# Autodesk Inventor assembly: Assembly2
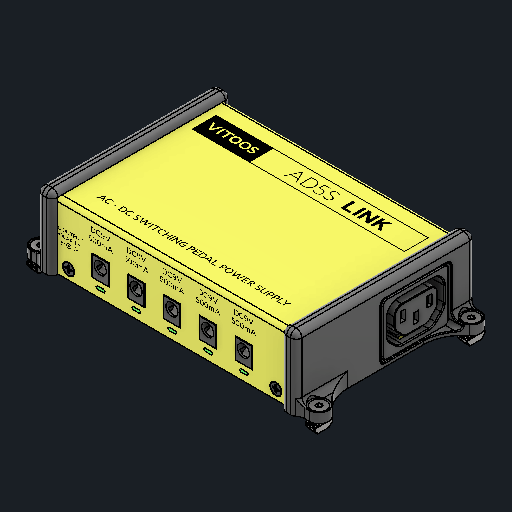
[picture p0: Inventor's stored thumbnail of the model, 512x512]
Saved by Autodesk Inventor 2026.2 (Build 302298000, 298)
## iProperties
Created: 2026-10-31
Part Number: Assembly2
Document SubType Name: Assembly
Designer: JoshuaEah
Author: JoshuaEah
## Documents named in this file (6)
- C:\Users\JoshuaEah\Documents\GitHub\designs\Guitar\Modular Pedalboard\Pedals\Power Supply\PSU Assembly.iam
- C:\Users\JoshuaEah\Documents\GitHub\designs\Guitar\Modular Pedalboard\Pedals\Power Supply\VITOOS AD5S LINK.iam
- C:\Users\JoshuaEah\Documents\GitHub\designs\Guitar\Modular Pedalboard\Pedals\Power Supply\PSU Bracket A.ipt
- C:\Users\JoshuaEah\Documents\GitHub\designs\Guitar\Modular Pedalboard\Pedals\Power Supply\PSU Bracket B.ipt
- C:\Users\JoshuaEah\Documents\GitHub\designs\Common Hardware\M4x0.7x10mm FHCS.ipt
- C:\Users\JoshuaEah\Documents\GitHub\designs\Common Hardware\M4x0.7 T-Slot Nut.ipt
## Components (11 placed, 5 different names)
1. VITOOS AD5S LINK:1 [sub-assembly] — Mate:3, Mate:4, Mate:8, Mate:9, Mate:10, Mate:11
2. PSU Bracket A:1 — Mate:3, Mate:4, Mate:8, Insert:1, Insert:2, Insert:5, Insert:6, Angle:1, Angle:2
3. PSU Bracket B:1 — Mate:9, Mate:10, Mate:11, Insert:3, Insert:4, Insert:7, Insert:8, Angle:3, Angle:4
4. M4x0.7x10mm FHCS:1 — Insert:1
5. M4x0.7x10mm FHCS:2 — Insert:2
6. M4x0.7x10mm FHCS:3 — Insert:3
7. M4x0.7x10mm FHCS:4 — Insert:4
8. M4x0.7 T-Slot Nut:1 — Insert:5, Angle:1
9. M4x0.7 T-Slot Nut:2 — Insert:6, Angle:2
10. M4x0.7 T-Slot Nut:3 — Insert:7, Angle:4
11. M4x0.7 T-Slot Nut:4 — Insert:8, Angle:3
## Relationships (18: Insert 8, Mate 6, Angle 4)
- Mate:3: VITOOS AD5S LINK:1 ↔ PSU Bracket A:1
- Mate:4: VITOOS AD5S LINK:1 ↔ PSU Bracket A:1
- Mate:8: VITOOS AD5S LINK:1 ↔ PSU Bracket A:1
- Mate:9: VITOOS AD5S LINK:1 ↔ PSU Bracket B:1
- Mate:10: VITOOS AD5S LINK:1 ↔ PSU Bracket B:1
- Mate:11: VITOOS AD5S LINK:1 ↔ PSU Bracket B:1
- Insert:1: PSU Bracket A:1 ↔ M4x0.7x10mm FHCS:1
- Insert:2: PSU Bracket A:1 ↔ M4x0.7x10mm FHCS:2
- Insert:3: PSU Bracket B:1 ↔ M4x0.7x10mm FHCS:3
- Insert:4: PSU Bracket B:1 ↔ M4x0.7x10mm FHCS:4
- Insert:5 (0.7 mm): PSU Bracket A:1 ↔ M4x0.7 T-Slot Nut:1
- Insert:6 (0.7 mm): PSU Bracket A:1 ↔ M4x0.7 T-Slot Nut:2
- Insert:7 (0.7 mm): PSU Bracket B:1 ↔ M4x0.7 T-Slot Nut:3
- Insert:8 (0.7 mm): PSU Bracket B:1 ↔ M4x0.7 T-Slot Nut:4
- Angle:1 (0 deg): PSU Bracket A:1 ↔ M4x0.7 T-Slot Nut:1
- Angle:2 (0 deg): PSU Bracket A:1 ↔ M4x0.7 T-Slot Nut:2
- Angle:3 (0 deg): PSU Bracket B:1 ↔ M4x0.7 T-Slot Nut:4
- Angle:4 (0 deg): PSU Bracket B:1 ↔ M4x0.7 T-Slot Nut:3
